# Autodesk Inventor assembly: Ensemble11
(part 2 of 2)
Density: 1 g/cm^3
Appearance: Par défaut
Author: User
Revision Number: NONE
## iProperties of the stored document DGND2.ipt
Created: 2026-11-11
Part Number: DGND2
Material: Générique
Description: PART--DESC
Document SubType Name: Modeling
Designer: User
Density: 1 g/cm^3
Appearance: Par défaut
Author: User
Revision Number: NONE
## iProperties of the stored document P2_1.ipt
Created: 2026-11-11
Part Number: P2
Material: Générique
Description: PART--DESC
Document SubType Name: Modeling
Designer: User
Density: 1 g/cm^3
Appearance: Par défaut
Author: User
Revision Number: NONE
## iProperties of the stored document P1_2.ipt
Created: 2026-11-11
Part Number: P1
Material: Générique
Description: PART--DESC
Document SubType Name: Modeling
Designer: User
Density: 1 g/cm^3
Appearance: Par défaut
Author: User
Revision Number: NONE
## iProperties of the stored document 1_20.ipt
Created: 2026-11-11
Part Number: 1
Material: Générique
Description: PART--DESC
Document SubType Name: Modeling
Designer: User
Density: 1 g/cm^3
Appearance: Par défaut
Author: User
Revision Number: NONE
## iProperties of the stored document 1_13.ipt
Created: 2026-11-11
Part Number: 1
Material: Générique
Description: PART--DESC
Document SubType Name: Modeling
Designer: User
Density: 1 g/cm^3
Appearance: Par défaut
Author: User
Revision Number: NONE
## iProperties of the stored document Camera_module_3_std_model_simple.iam
Created: 2024-01-23
Part Number: Camera_module_3_std_model_simple
Description: STEP AP214
Document SubType Name: Assembly
Designer: User
Title: Camera_module_3_std_model_simple.stp
Revision Number: NONE
Preprocessor: Spatial InterOp 3D
## Documents named in this file (203)
- **D:\Documents\Tibo\ECOLE\NTUST\Intelligent_Control_Systems\Underwater_swarm_project\hardware\CAD_underwater_swarm_project\electronics\RP-008154-DS-1-camera-module-3-step\Ensemble11.iam*LocalDocs*xAaaaq3caAaaaaaaaAaaaqmb0Pf*RESC1005X40N_3.ipt
- **D:\Documents\Tibo\ECOLE\NTUST\Intelligent_Control_Systems\Underwater_swarm_project\hardware\CAD_underwater_swarm_project\electronics\RP-008154-DS-1-camera-module-3-step\Ensemble11.iam*LocalDocs*xAaaaakcaAaaaaaaaAaaaatpnOc*SOT95P280X145-5N_1.ipt
- **D:\Documents\Tibo\ECOLE\NTUST\Intelligent_Control_Systems\Underwater_swarm_project\hardware\CAD_underwater_swarm_project\electronics\RP-008154-DS-1-camera-module-3-step\Ensemble11.iam*LocalDocs*xAaaaaacaAaaaaaaaAaaaq4cuKg*MURATA_DLP11SNXXXHL2.ipt
- **D:\Documents\Tibo\ECOLE\NTUST\Intelligent_Control_Systems\Underwater_swarm_project\hardware\CAD_underwater_swarm_project\electronics\RP-008154-DS-1-camera-module-3-step\Ensemble11.iam*LocalDocs*xAaaaa2aaAaaaaaaaAaaaaoziVc*S2_1.ipt
- **D:\Documents\Tibo\ECOLE\NTUST\Intelligent_Control_Systems\Underwater_swarm_project\hardware\CAD_underwater_swarm_project\electronics\RP-008154-DS-1-camera-module-3-step\Ensemble11.iam*LocalDocs*xAaaaa0caAaaaaaaaAaaaapexYe*NC1.ipt
- **D:\Documents\Tibo\ECOLE\NTUST\Intelligent_Control_Systems\Underwater_swarm_project\hardware\CAD_underwater_swarm_project\electronics\RP-008154-DS-1-camera-module-3-step\Ensemble11.iam*LocalDocs*xAaaaa0baAaaaaaaaAaaaqoilAa*MECHANICAL PIN.ipt
- **D:\Documents\Tibo\ECOLE\NTUST\Intelligent_Control_Systems\Underwater_swarm_project\hardware\CAD_underwater_swarm_project\electronics\RP-008154-DS-1-camera-module-3-step\Ensemble11.iam*LocalDocs*xAaaaa0baAaaaaaaaAaaaaho3Hb*2_22.ipt
- **D:\Documents\Tibo\ECOLE\NTUST\Intelligent_Control_Systems\Underwater_swarm_project\hardware\CAD_underwater_swarm_project\electronics\RP-008154-DS-1-camera-module-3-step\Ensemble11.iam*LocalDocs*xAaaaa0caAaaaaaaaAaaaa30g1a*AFVDD.ipt
- **D:\Documents\Tibo\ECOLE\NTUST\Intelligent_Control_Systems\Underwater_swarm_project\hardware\CAD_underwater_swarm_project\electronics\RP-008154-DS-1-camera-module-3-step\Ensemble11.iam*LocalDocs*xAaaaa0caAaaaaaaaAaaaa4deZg*2_17.ipt
- **D:\Documents\Tibo\ECOLE\NTUST\Intelligent_Control_Systems\Underwater_swarm_project\hardware\CAD_underwater_swarm_project\electronics\RP-008154-DS-1-camera-module-3-step\Ensemble11.iam*LocalDocs*xAaaaa0daAaaaaaaaAaaaqxc0Ec*CAPC2012.ipt
- **D:\Documents\Tibo\ECOLE\NTUST\Intelligent_Control_Systems\Underwater_swarm_project\hardware\CAD_underwater_swarm_project\electronics\RP-008154-DS-1-camera-module-3-step\Ensemble11.iam*LocalDocs*xAaaaa0daAaaaaaaaAaaaqupxTc*1_16.ipt
- **D:\Documents\Tibo\ECOLE\NTUST\Intelligent_Control_Systems\Underwater_swarm_project\hardware\CAD_underwater_swarm_project\electronics\RP-008154-DS-1-camera-module-3-step\Ensemble11.iam*LocalDocs*xAaaaa0daAaaaaaaaAaaaqh0qBd*CAPC1005X55N.ipt
- **D:\Documents\Tibo\ECOLE\NTUST\Intelligent_Control_Systems\Underwater_swarm_project\hardware\CAD_underwater_swarm_project\electronics\RP-008154-DS-1-camera-module-3-step\Ensemble11.iam*LocalDocs*xAaaaa0caAaaaaaaaAaaaqjyvSd*1_4.ipt
- **D:\Documents\Tibo\ECOLE\NTUST\Intelligent_Control_Systems\Underwater_swarm_project\hardware\CAD_underwater_swarm_project\electronics\RP-008154-DS-1-camera-module-3-step\Ensemble11.iam*LocalDocs*xAaaaa0daAaaaaaaaAaaaqx4eFf*1_10.ipt
- **D:\Documents\Tibo\ECOLE\NTUST\Intelligent_Control_Systems\Underwater_swarm_project\hardware\CAD_underwater_swarm_project\electronics\RP-008154-DS-1-camera-module-3-step\Ensemble11.iam*LocalDocs*xAaaaa1caAaaaaaaaAaaaaezlSg*2.ipt
- **D:\Documents\Tibo\ECOLE\NTUST\Intelligent_Control_Systems\Underwater_swarm_project\hardware\CAD_underwater_swarm_project\electronics\RP-008154-DS-1-camera-module-3-step\Ensemble11.iam*LocalDocs*xAaaaa1aaAaaaaaaaAaaaqjprSd*NC1_1.ipt
- **D:\Documents\Tibo\ECOLE\NTUST\Intelligent_Control_Systems\Underwater_swarm_project\hardware\CAD_underwater_swarm_project\electronics\RP-008154-DS-1-camera-module-3-step\Ensemble11.iam*LocalDocs*xAaaaa1daAaaaaaaaAaaaq4cbNf*NC2.ipt
- **D:\Documents\Tibo\ECOLE\NTUST\Intelligent_Control_Systems\Underwater_swarm_project\hardware\CAD_underwater_swarm_project\electronics\RP-008154-DS-1-camera-module-3-step\Ensemble11.iam*LocalDocs*xAaaaa1daAaaaaaaaAaaaawxwAf*15.ipt
- **D:\Documents\Tibo\ECOLE\NTUST\Intelligent_Control_Systems\Underwater_swarm_project\hardware\CAD_underwater_swarm_project\electronics\RP-008154-DS-1-camera-module-3-step\Ensemble11.iam*LocalDocs*xAaaaa1daAaaaaaaaAaaaqe1cPg*1_3.ipt
- **D:\Documents\Tibo\ECOLE\NTUST\Intelligent_Control_Systems\Underwater_swarm_project\hardware\CAD_underwater_swarm_project\electronics\RP-008154-DS-1-camera-module-3-step\Ensemble11.iam*LocalDocs*xAaaaa3daAaaaaaaaAaaaag1kLd*CAPC1608X90N.ipt
- **D:\Documents\Tibo\ECOLE\NTUST\Intelligent_Control_Systems\Underwater_swarm_project\hardware\CAD_underwater_swarm_project\electronics\RP-008154-DS-1-camera-module-3-step\Ensemble11.iam*LocalDocs*xAaaaa3caAaaaaaaaAaaaaj3r2f*CAPC1005X55N_4.ipt
- **D:\Documents\Tibo\ECOLE\NTUST\Intelligent_Control_Systems\Underwater_swarm_project\hardware\CAD_underwater_swarm_project\electronics\RP-008154-DS-1-camera-module-3-step\Ensemble11.iam*LocalDocs*xAaaaa3aaAaaaaaaaAaaaq2yaZg*1_5.ipt
- **D:\Documents\Tibo\ECOLE\NTUST\Intelligent_Control_Systems\Underwater_swarm_project\hardware\CAD_underwater_swarm_project\electronics\RP-008154-DS-1-camera-module-3-step\Ensemble11.iam*LocalDocs*xAaaaa2caAaaaaaaaAaaaahiqGc*MD1N.ipt
- **D:\Documents\Tibo\ECOLE\NTUST\Intelligent_Control_Systems\Underwater_swarm_project\hardware\CAD_underwater_swarm_project\electronics\RP-008154-DS-1-camera-module-3-step\Ensemble11.iam*LocalDocs*xAaaaa3caAaaaaaaaAaaaa3cwCb*NC2_2.ipt
- **D:\Documents\Tibo\ECOLE\NTUST\Intelligent_Control_Systems\Underwater_swarm_project\hardware\CAD_underwater_swarm_project\electronics\RP-008154-DS-1-camera-module-3-step\Ensemble11.iam*LocalDocs*xAaaaa3daAaaaaaaaAaaaa3ktJe*P3.ipt
- **D:\Documents\Tibo\ECOLE\NTUST\Intelligent_Control_Systems\Underwater_swarm_project\hardware\CAD_underwater_swarm_project\electronics\RP-008154-DS-1-camera-module-3-step\Ensemble11.iam*LocalDocs*xAaaaa5baAaaaaaaaAaaaqmyaMe*GND_2.ipt
- **D:\Documents\Tibo\ECOLE\NTUST\Intelligent_Control_Systems\Underwater_swarm_project\hardware\CAD_underwater_swarm_project\electronics\RP-008154-DS-1-camera-module-3-step\Ensemble11.iam*LocalDocs*xAaaaa4caAaaaaaaaAaaaaqewTe*DGND8.ipt
- **D:\Documents\Tibo\ECOLE\NTUST\Intelligent_Control_Systems\Underwater_swarm_project\hardware\CAD_underwater_swarm_project\electronics\RP-008154-DS-1-camera-module-3-step\Ensemble11.iam*LocalDocs*xAaaaa4caAaaaaaaaAaaaanuhYb*2_1.ipt
- **D:\Documents\Tibo\ECOLE\NTUST\Intelligent_Control_Systems\Underwater_swarm_project\hardware\CAD_underwater_swarm_project\electronics\RP-008154-DS-1-camera-module-3-step\Ensemble11.iam*LocalDocs*xAaaaa4aaAaaaaaaaAaaaqdlfUc*1_24.ipt
- **D:\Documents\Tibo\ECOLE\NTUST\Intelligent_Control_Systems\Underwater_swarm_project\hardware\CAD_underwater_swarm_project\electronics\RP-008154-DS-1-camera-module-3-step\Ensemble11.iam*LocalDocs*xAaaaa5aaAaaaaaaaAaaaqanu1g*P1.ipt
- **D:\Documents\Tibo\ECOLE\NTUST\Intelligent_Control_Systems\Underwater_swarm_project\hardware\CAD_underwater_swarm_project\electronics\RP-008154-DS-1-camera-module-3-step\Ensemble11.iam*LocalDocs*xAaaaa5daAaaaaaaaAaaaar3nAf*DVDD_GPIO.ipt
- **D:\Documents\Tibo\ECOLE\NTUST\Intelligent_Control_Systems\Underwater_swarm_project\hardware\CAD_underwater_swarm_project\electronics\RP-008154-DS-1-camera-module-3-step\Ensemble11.iam*LocalDocs*xAaaaaddaAaaaaaaaAaaaask0Ob*VCC.ipt
- **D:\Documents\Tibo\ECOLE\NTUST\Intelligent_Control_Systems\Underwater_swarm_project\hardware\CAD_underwater_swarm_project\electronics\RP-008154-DS-1-camera-module-3-step\Ensemble11.iam*LocalDocs*xAaaaacdaAaaaaaaaAaaaqht53b*EXP_PAD.ipt
- **D:\Documents\Tibo\ECOLE\NTUST\Intelligent_Control_Systems\Underwater_swarm_project\hardware\CAD_underwater_swarm_project\electronics\RP-008154-DS-1-camera-module-3-step\Ensemble11.iam*LocalDocs*xAaaaacaaAaaaaaaaAaaaaoo23b*PG.ipt
- **D:\Documents\Tibo\ECOLE\NTUST\Intelligent_Control_Systems\Underwater_swarm_project\hardware\CAD_underwater_swarm_project\electronics\RP-008154-DS-1-camera-module-3-step\Ensemble11.iam*LocalDocs*xAaaaabdaAaaaaaaaAaaaahbvWa*VDD.ipt
- **D:\Documents\Tibo\ECOLE\NTUST\Intelligent_Control_Systems\Underwater_swarm_project\hardware\CAD_underwater_swarm_project\electronics\RP-008154-DS-1-camera-module-3-step\Ensemble11.iam*LocalDocs*xAaaaabaaAaaaaaaaAaaaqwccBa*G2_1.ipt
- **D:\Documents\Tibo\ECOLE\NTUST\Intelligent_Control_Systems\Underwater_swarm_project\hardware\CAD_underwater_swarm_project\electronics\RP-008154-DS-1-camera-module-3-step\Ensemble11.iam*LocalDocs*xAaaaabdaAaaaaaaaAaaaqdzbBh*GND_1.ipt
- **D:\Documents\Tibo\ECOLE\NTUST\Intelligent_Control_Systems\Underwater_swarm_project\hardware\CAD_underwater_swarm_project\electronics\RP-008154-DS-1-camera-module-3-step\Ensemble11.iam*LocalDocs*xAaaaabdaAaaaaaaaAaaaqi2wRc*12.ipt
- **D:\Documents\Tibo\ECOLE\NTUST\Intelligent_Control_Systems\Underwater_swarm_project\hardware\CAD_underwater_swarm_project\electronics\RP-008154-DS-1-camera-module-3-step\Ensemble11.iam*LocalDocs*xAaaaacdaAaaaaaaaAaaaaiu03a*CAPC1608X90N_1.ipt
- **D:\Documents\Tibo\ECOLE\NTUST\Intelligent_Control_Systems\Underwater_swarm_project\hardware\CAD_underwater_swarm_project\electronics\RP-008154-DS-1-camera-module-3-step\Ensemble11.iam*LocalDocs*xAaaaadcaAaaaaaaaAaaaap5fSc*RESC1005X40N_4.ipt
- **D:\Documents\Tibo\ECOLE\NTUST\Intelligent_Control_Systems\Underwater_swarm_project\hardware\CAD_underwater_swarm_project\electronics\RP-008154-DS-1-camera-module-3-step\Ensemble11.iam*LocalDocs*xAaaaadbaAaaaaaaaAaaaaydeUc*2_5.ipt
- **D:\Documents\Tibo\ECOLE\NTUST\Intelligent_Control_Systems\Underwater_swarm_project\hardware\CAD_underwater_swarm_project\electronics\RP-008154-DS-1-camera-module-3-step\Ensemble11.iam*LocalDocs*xAaaaadaaAaaaaaaaAaaaaixaGf*1_22.ipt
- **D:\Documents\Tibo\ECOLE\NTUST\Intelligent_Control_Systems\Underwater_swarm_project\hardware\CAD_underwater_swarm_project\electronics\RP-008154-DS-1-camera-module-3-step\Ensemble11.iam*LocalDocs*xAaaaadbaAaaaaaaaAaaaqldhHd*G2.ipt
- **D:\Documents\Tibo\ECOLE\NTUST\Intelligent_Control_Systems\Underwater_swarm_project\hardware\CAD_underwater_swarm_project\electronics\RP-008154-DS-1-camera-module-3-step\Ensemble11.iam*LocalDocs*xAaaaaddaAaaaaaaaAaaaaqakVc*ATMEL_ATSHA204A_SOIC8.ipt
- **D:\Documents\Tibo\ECOLE\NTUST\Intelligent_Control_Systems\Underwater_swarm_project\hardware\CAD_underwater_swarm_project\electronics\RP-008154-DS-1-camera-module-3-step\Ensemble11.iam*LocalDocs*xAaaaadcaAaaaaaaaAaaaqixr2b*MD1P.ipt
- **D:\Documents\Tibo\ECOLE\NTUST\Intelligent_Control_Systems\Underwater_swarm_project\hardware\CAD_underwater_swarm_project\electronics\RP-008154-DS-1-camera-module-3-step\Ensemble11.iam*LocalDocs*xAaaaaicaAaaaaaaaAaaaapk0Id*SCL.ipt
- **D:\Documents\Tibo\ECOLE\NTUST\Intelligent_Control_Systems\Underwater_swarm_project\hardware\CAD_underwater_swarm_project\electronics\RP-008154-DS-1-camera-module-3-step\Ensemble11.iam*LocalDocs*xAaaaagdaAaaaaaaaAaaaa1dwOd*2_21.ipt
- **D:\Documents\Tibo\ECOLE\NTUST\Intelligent_Control_Systems\Underwater_swarm_project\hardware\CAD_underwater_swarm_project\electronics\RP-008154-DS-1-camera-module-3-step\Ensemble11.iam*LocalDocs*xAaaaagbaAaaaaaaaAaaaa0wlHa*CAPC1005X55N_1.ipt
- **D:\Documents\Tibo\ECOLE\NTUST\Intelligent_Control_Systems\Underwater_swarm_project\hardware\CAD_underwater_swarm_project\electronics\RP-008154-DS-1-camera-module-3-step\Ensemble11.iam*LocalDocs*xAaaaaecaAaaaaaaaAaaaazxhGb*SDA.ipt
- **D:\Documents\Tibo\ECOLE\NTUST\Intelligent_Control_Systems\Underwater_swarm_project\hardware\CAD_underwater_swarm_project\electronics\RP-008154-DS-1-camera-module-3-step\Ensemble11.iam*LocalDocs*xAaaaagaaAaaaaaaaAaaaqolcLd*1_7.ipt
- **D:\Documents\Tibo\ECOLE\NTUST\Intelligent_Control_Systems\Underwater_swarm_project\hardware\CAD_underwater_swarm_project\electronics\RP-008154-DS-1-camera-module-3-step\Ensemble11.iam*LocalDocs*xAaaaagbaAaaaaaaaAaaaqvkuBg*1_14.ipt
- **D:\Documents\Tibo\ECOLE\NTUST\Intelligent_Control_Systems\Underwater_swarm_project\hardware\CAD_underwater_swarm_project\electronics\RP-008154-DS-1-camera-module-3-step\Ensemble11.iam*LocalDocs*xAaaaaiaaAaaaaaaaAaaaq4fxAg*2_23.ipt
- **D:\Documents\Tibo\ECOLE\NTUST\Intelligent_Control_Systems\Underwater_swarm_project\hardware\CAD_underwater_swarm_project\electronics\RP-008154-DS-1-camera-module-3-step\Ensemble11.iam*LocalDocs*xAaaaaiaaAaaaaaaaAaaaa2p5Gf*2_3.ipt
- **D:\Documents\Tibo\ECOLE\NTUST\Intelligent_Control_Systems\Underwater_swarm_project\hardware\CAD_underwater_swarm_project\electronics\RP-008154-DS-1-camera-module-3-step\Ensemble11.iam*LocalDocs*xAaaaahbaAaaaaaaaAaaaqledLc*1.ipt
- **D:\Documents\Tibo\ECOLE\NTUST\Intelligent_Control_Systems\Underwater_swarm_project\hardware\CAD_underwater_swarm_project\electronics\RP-008154-DS-1-camera-module-3-step\Ensemble11.iam*LocalDocs*xAaaaaibaAaaaaaaaAaaaaiedIe*LX.ipt
- **D:\Documents\Tibo\ECOLE\NTUST\Intelligent_Control_Systems\Underwater_swarm_project\hardware\CAD_underwater_swarm_project\electronics\RP-008154-DS-1-camera-module-3-step\Ensemble11.iam*LocalDocs*xAaaaajaaAaaaaaaaAaaaaghbLb*P4_2.ipt
- **D:\Documents\Tibo\ECOLE\NTUST\Intelligent_Control_Systems\Underwater_swarm_project\hardware\CAD_underwater_swarm_project\electronics\RP-008154-DS-1-camera-module-3-step\Ensemble11.iam*LocalDocs*xAaaaaicaAaaaaaaaAaaaqbqu2f*8.ipt
- **D:\Documents\Tibo\ECOLE\NTUST\Intelligent_Control_Systems\Underwater_swarm_project\hardware\CAD_underwater_swarm_project\electronics\RP-008154-DS-1-camera-module-3-step\Ensemble11.iam*LocalDocs*xAaaaakbaAaaaaaaaAaaaqlrc5g*MCKP.ipt
- **D:\Documents\Tibo\ECOLE\NTUST\Intelligent_Control_Systems\Underwater_swarm_project\hardware\CAD_underwater_swarm_project\electronics\RP-008154-DS-1-camera-module-3-step\Ensemble11.iam*LocalDocs*xAaaaajdaAaaaaaaaAaaaaywoSc*DVDD.ipt
- **D:\Documents\Tibo\ECOLE\NTUST\Intelligent_Control_Systems\Underwater_swarm_project\hardware\CAD_underwater_swarm_project\electronics\RP-008154-DS-1-camera-module-3-step\Ensemble11.iam*LocalDocs*xAaaaaraaAaaaaaaaAaaaab434f*VO1V8.ipt
- **D:\Documents\Tibo\ECOLE\NTUST\Intelligent_Control_Systems\Underwater_swarm_project\hardware\CAD_underwater_swarm_project\electronics\RP-008154-DS-1-camera-module-3-step\Ensemble11.iam*LocalDocs*xAaaaaodaAaaaaaaaAaaaavohMa*ATMEL_ATSHA204A_8UDFN.ipt
- **D:\Documents\Tibo\ECOLE\NTUST\Intelligent_Control_Systems\Underwater_swarm_project\hardware\CAD_underwater_swarm_project\electronics\RP-008154-DS-1-camera-module-3-step\Ensemble11.iam*LocalDocs*xAaaaanbaAaaaaaaaAaaaayklCa*DGND3.ipt
- **D:\Documents\Tibo\ECOLE\NTUST\Intelligent_Control_Systems\Underwater_swarm_project\hardware\CAD_underwater_swarm_project\electronics\RP-008154-DS-1-camera-module-3-step\Ensemble11.iam*LocalDocs*xAaaaamaaAaaaaaaaAaaaqpq43e*7.ipt
- **D:\Documents\Tibo\ECOLE\NTUST\Intelligent_Control_Systems\Underwater_swarm_project\hardware\CAD_underwater_swarm_project\electronics\RP-008154-DS-1-camera-module-3-step\Ensemble11.iam*LocalDocs*xAaaaalcaAaaaaaaaAaaaqzdtUd*D2_1.ipt
- **D:\Documents\Tibo\ECOLE\NTUST\Intelligent_Control_Systems\Underwater_swarm_project\hardware\CAD_underwater_swarm_project\electronics\RP-008154-DS-1-camera-module-3-step\Ensemble11.iam*LocalDocs*xAaaaakcaAaaaaaaaAaaaqdztIf*1_2.ipt
- **D:\Documents\Tibo\ECOLE\NTUST\Intelligent_Control_Systems\Underwater_swarm_project\hardware\CAD_underwater_swarm_project\electronics\RP-008154-DS-1-camera-module-3-step\Ensemble11.iam*LocalDocs*xAaaaalaaAaaaaaaaAaaaajuyCe*_PWDN.ipt
- **D:\Documents\Tibo\ECOLE\NTUST\Intelligent_Control_Systems\Underwater_swarm_project\hardware\CAD_underwater_swarm_project\electronics\RP-008154-DS-1-camera-module-3-step\Ensemble11.iam*LocalDocs*xAaaaaldaAaaaaaaaAaaaqsx33f*1_1.ipt
- **D:\Documents\Tibo\ECOLE\NTUST\Intelligent_Control_Systems\Underwater_swarm_project\hardware\CAD_underwater_swarm_project\electronics\RP-008154-DS-1-camera-module-3-step\Ensemble11.iam*LocalDocs*xAaaaambaAaaaaaaaAaaaass0Va*OUTPUT.ipt
- **D:\Documents\Tibo\ECOLE\NTUST\Intelligent_Control_Systems\Underwater_swarm_project\hardware\CAD_underwater_swarm_project\electronics\RP-008154-DS-1-camera-module-3-step\Ensemble11.iam*LocalDocs*xAaaaaoaaAaaaaaaaAaaaqalgOg*CAPC1005X55N_2.ipt
- **D:\Documents\Tibo\ECOLE\NTUST\Intelligent_Control_Systems\Underwater_swarm_project\hardware\CAD_underwater_swarm_project\electronics\RP-008154-DS-1-camera-module-3-step\Ensemble11.iam*LocalDocs*xAaaaandaAaaaaaaaAaaaqwfnDb*CAPC1005X55N_5.ipt
- **D:\Documents\Tibo\ECOLE\NTUST\Intelligent_Control_Systems\Underwater_swarm_project\hardware\CAD_underwater_swarm_project\electronics\RP-008154-DS-1-camera-module-3-step\Ensemble11.iam*LocalDocs*xAaaaaocaAaaaaaaaAaaaanebPb*EN_1.ipt
- **D:\Documents\Tibo\ECOLE\NTUST\Intelligent_Control_Systems\Underwater_swarm_project\hardware\CAD_underwater_swarm_project\electronics\RP-008154-DS-1-camera-module-3-step\Ensemble11.iam*LocalDocs*xAaaaaoaaAaaaaaaaAaaaqic3Qg*2_9.ipt
- **D:\Documents\Tibo\ECOLE\NTUST\Intelligent_Control_Systems\Underwater_swarm_project\hardware\CAD_underwater_swarm_project\electronics\RP-008154-DS-1-camera-module-3-step\Ensemble11.iam*LocalDocs*xAaaaaocaAaaaaaaaAaaaqk2sSc*OE.ipt
- **D:\Documents\Tibo\ECOLE\NTUST\Intelligent_Control_Systems\Underwater_swarm_project\hardware\CAD_underwater_swarm_project\electronics\RP-008154-DS-1-camera-module-3-step\Ensemble11.iam*LocalDocs*xAaaaaqcaAaaaaaaaAaaaa5znVf*MURATA_DLP11SNXXXHL2_2.ipt
- **D:\Documents\Tibo\ECOLE\NTUST\Intelligent_Control_Systems\Underwater_swarm_project\hardware\CAD_underwater_swarm_project\electronics\RP-008154-DS-1-camera-module-3-step\Ensemble11.iam*LocalDocs*xAaaaapaaAaaaaaaaAaaaqle5Ch*P2.ipt
- **D:\Documents\Tibo\ECOLE\NTUST\Intelligent_Control_Systems\Underwater_swarm_project\hardware\CAD_underwater_swarm_project\electronics\RP-008154-DS-1-camera-module-3-step\Ensemble11.iam*LocalDocs*xAaaaapaaAaaaaaaaAaaaanlw1a*NC2_1.ipt
- **D:\Documents\Tibo\ECOLE\NTUST\Intelligent_Control_Systems\Underwater_swarm_project\hardware\CAD_underwater_swarm_project\electronics\RP-008154-DS-1-camera-module-3-step\Ensemble11.iam*LocalDocs*xAaaaaqcaAaaaaaaaAaaaaswdYd*Shapes.iam
- **D:\Documents\Tibo\ECOLE\NTUST\Intelligent_Control_Systems\Underwater_swarm_project\hardware\CAD_underwater_swarm_project\electronics\RP-008154-DS-1-camera-module-3-step\Ensemble11.iam*LocalDocs*xAaaaqeaaAaaaaaaaAaaaava3He*SILKSCREEN_TOP.ipt
- **D:\Documents\Tibo\ECOLE\NTUST\Intelligent_Control_Systems\Underwater_swarm_project\hardware\CAD_underwater_swarm_project\electronics\RP-008154-DS-1-camera-module-3-step\Ensemble11.iam*LocalDocs*xAaaaq2aaAaaaaaaaAaaaq4ynBf*PASTEMASK_TOP.ipt
- **D:\Documents\Tibo\ECOLE\NTUST\Intelligent_Control_Systems\Underwater_swarm_project\hardware\CAD_underwater_swarm_project\electronics\RP-008154-DS-1-camera-module-3-step\Ensemble11.iam*LocalDocs*xAaaaqcbaAaaaaaaaAaaaqzlqJg*SOLDERMASK_TOP.ipt
- **D:\Documents\Tibo\ECOLE\NTUST\Intelligent_Control_Systems\Underwater_swarm_project\hardware\CAD_underwater_swarm_project\electronics\RP-008154-DS-1-camera-module-3-step\Ensemble11.iam*LocalDocs*xAaaaqucaAaaaaaaaAaaaq3ckGd*Dielectric.ipt
- **D:\Documents\Tibo\ECOLE\NTUST\Intelligent_Control_Systems\Underwater_swarm_project\hardware\CAD_underwater_swarm_project\electronics\RP-008154-DS-1-camera-module-3-step\Ensemble11.iam*LocalDocs*xAaaaqfbaAaaaaaaaAaaaac4sNf*SOLDERMASK_BOTTOM.ipt
- **D:\Documents\Tibo\ECOLE\NTUST\Intelligent_Control_Systems\Underwater_swarm_project\hardware\CAD_underwater_swarm_project\electronics\RP-008154-DS-1-camera-module-3-step\Ensemble11.iam*LocalDocs*xAaaaq4aaAaaaaaaaAaaaaka5Fa*PASTEMASK_BOTTOM.ipt
- **D:\Documents\Tibo\ECOLE\NTUST\Intelligent_Control_Systems\Underwater_swarm_project\hardware\CAD_underwater_swarm_project\electronics\RP-008154-DS-1-camera-module-3-step\Ensemble11.iam*LocalDocs*xAaaaataaAaaaaaaaAaaaa25fTh*SILKSCREEN_BOTTOM.ipt
- **D:\Documents\Tibo\ECOLE\NTUST\Intelligent_Control_Systems\Underwater_swarm_project\hardware\CAD_underwater_swarm_project\electronics\RP-008154-DS-1-camera-module-3-step\Ensemble11.iam*LocalDocs*xAaaaaqcaAaaaaaaaAaaaassyQh*GND_6.ipt
- **D:\Documents\Tibo\ECOLE\NTUST\Intelligent_Control_Systems\Underwater_swarm_project\hardware\CAD_underwater_swarm_project\electronics\RP-008154-DS-1-camera-module-3-step\Ensemble11.iam*LocalDocs*xAaaaaudaAaaaaaaaAaaaq0wy3a*RESC1005X40N_1.ipt
- **D:\Documents\Tibo\ECOLE\NTUST\Intelligent_Control_Systems\Underwater_swarm_project\hardware\CAD_underwater_swarm_project\electronics\RP-008154-DS-1-camera-module-3-step\Ensemble11.iam*LocalDocs*xAaaaascaAaaaaaaaAaaaqvdpYg*P4.ipt
- **D:\Documents\Tibo\ECOLE\NTUST\Intelligent_Control_Systems\Underwater_swarm_project\hardware\CAD_underwater_swarm_project\electronics\RP-008154-DS-1-camera-module-3-step\Ensemble11.iam*LocalDocs*xAaaaarcaAaaaaaaaAaaaq03kGe*NC3.ipt
- **D:\Documents\Tibo\ECOLE\NTUST\Intelligent_Control_Systems\Underwater_swarm_project\hardware\CAD_underwater_swarm_project\electronics\RP-008154-DS-1-camera-module-3-step\Ensemble11.iam*LocalDocs*xAaaaaraaAaaaaaaaAaaaqquqDe*MECHANICAL PIN_2.ipt
- **D:\Documents\Tibo\ECOLE\NTUST\Intelligent_Control_Systems\Underwater_swarm_project\hardware\CAD_underwater_swarm_project\electronics\RP-008154-DS-1-camera-module-3-step\Ensemble11.iam*LocalDocs*xAaaaardaAaaaaaaaAaaaqvfcJc*NC6.ipt
- **D:\Documents\Tibo\ECOLE\NTUST\Intelligent_Control_Systems\Underwater_swarm_project\hardware\CAD_underwater_swarm_project\electronics\RP-008154-DS-1-camera-module-3-step\Ensemble11.iam*LocalDocs*xAaaaardaAaaaaaaaAaaaav2gTh*GND_3.ipt
- **D:\Documents\Tibo\ECOLE\NTUST\Intelligent_Control_Systems\Underwater_swarm_project\hardware\CAD_underwater_swarm_project\electronics\RP-008154-DS-1-camera-module-3-step\Ensemble11.iam*LocalDocs*xAaaaasaaAaaaaaaaAaaaarafNa*DGND6.ipt
- **D:\Documents\Tibo\ECOLE\NTUST\Intelligent_Control_Systems\Underwater_swarm_project\hardware\CAD_underwater_swarm_project\electronics\RP-008154-DS-1-camera-module-3-step\Ensemble11.iam*LocalDocs*xAaaaasdaAaaaaaaaAaaaaubtSb*P4_1.ipt
- **D:\Documents\Tibo\ECOLE\NTUST\Intelligent_Control_Systems\Underwater_swarm_project\hardware\CAD_underwater_swarm_project\electronics\RP-008154-DS-1-camera-module-3-step\Ensemble11.iam*LocalDocs*xAaaaaucaAaaaaaaaAaaaanimEg*2_14.ipt
- **D:\Documents\Tibo\ECOLE\NTUST\Intelligent_Control_Systems\Underwater_swarm_project\hardware\CAD_underwater_swarm_project\electronics\RP-008154-DS-1-camera-module-3-step\Ensemble11.iam*LocalDocs*xAaaaataaAaaaaaaaAaaaajgq0b*FCI_SFW15R-1STE1LF.ipt
- **D:\Documents\Tibo\ECOLE\NTUST\Intelligent_Control_Systems\Underwater_swarm_project\hardware\CAD_underwater_swarm_project\electronics\RP-008154-DS-1-camera-module-3-step\Ensemble11.iam*LocalDocs*xAaaaatdaAaaaaaaaAaaaqk3zNc*1_23.ipt
- **D:\Documents\Tibo\ECOLE\NTUST\Intelligent_Control_Systems\Underwater_swarm_project\hardware\CAD_underwater_swarm_project\electronics\RP-008154-DS-1-camera-module-3-step\Ensemble11.iam*LocalDocs*xAaaaaucaAaaaaaaaAaaaawafGc*P3_2.ipt
- **D:\Documents\Tibo\ECOLE\NTUST\Intelligent_Control_Systems\Underwater_swarm_project\hardware\CAD_underwater_swarm_project\electronics\RP-008154-DS-1-camera-module-3-step\Ensemble11.iam*LocalDocs*xAaaaq0aaAaaaaaaaAaaaqggeIe*CAPC1005X55N_8.ipt
- **D:\Documents\Tibo\ECOLE\NTUST\Intelligent_Control_Systems\Underwater_swarm_project\hardware\CAD_underwater_swarm_project\electronics\RP-008154-DS-1-camera-module-3-step\Ensemble11.iam*LocalDocs*xAaaaaxaaAaaaaaaaAaaaqbhoOa*CAPC1608.ipt
- **D:\Documents\Tibo\ECOLE\NTUST\Intelligent_Control_Systems\Underwater_swarm_project\hardware\CAD_underwater_swarm_project\electronics\RP-008154-DS-1-camera-module-3-step\Ensemble11.iam*LocalDocs*xAaaaavdaAaaaaaaaAaaaacdaPb*5.ipt
- **D:\Documents\Tibo\ECOLE\NTUST\Intelligent_Control_Systems\Underwater_swarm_project\hardware\CAD_underwater_swarm_project\electronics\RP-008154-DS-1-camera-module-3-step\Ensemble11.iam*LocalDocs*xAaaaaudaAaaaaaaaAaaaq5wmKb*RESC0603.ipt
- **D:\Documents\Tibo\ECOLE\NTUST\Intelligent_Control_Systems\Underwater_swarm_project\hardware\CAD_underwater_swarm_project\electronics\RP-008154-DS-1-camera-module-3-step\Ensemble11.iam*LocalDocs*xAaaaawcaAaaaaaaaAaaaqzmcFc*GND_5.ipt
- **D:\Documents\Tibo\ECOLE\NTUST\Intelligent_Control_Systems\Underwater_swarm_project\hardware\CAD_underwater_swarm_project\electronics\RP-008154-DS-1-camera-module-3-step\Ensemble11.iam*LocalDocs*xAaaaawaaAaaaaaaaAaaaaigz0c*1_15.ipt
- **D:\Documents\Tibo\ECOLE\NTUST\Intelligent_Control_Systems\Underwater_swarm_project\hardware\CAD_underwater_swarm_project\electronics\RP-008154-DS-1-camera-module-3-step\Ensemble11.iam*LocalDocs*xAaaaavdaAaaaaaaaAaaaappnId*Pins.iam
- **D:\Documents\Tibo\ECOLE\NTUST\Intelligent_Control_Systems\Underwater_swarm_project\hardware\CAD_underwater_swarm_project\electronics\RP-008154-DS-1-camera-module-3-step\Ensemble11.iam*LocalDocs*xAaaaqwaaAaaaaaaaAaaaqlbjEg*1_6.ipt
- **D:\Documents\Tibo\ECOLE\NTUST\Intelligent_Control_Systems\Underwater_swarm_project\hardware\CAD_underwater_swarm_project\electronics\RP-008154-DS-1-camera-module-3-step\Ensemble11.iam*LocalDocs*xAaaaqycaAaaaaaaaAaaaa2aiOh*1_8.ipt
- **D:\Documents\Tibo\ECOLE\NTUST\Intelligent_Control_Systems\Underwater_swarm_project\hardware\CAD_underwater_swarm_project\electronics\RP-008154-DS-1-camera-module-3-step\Ensemble11.iam*LocalDocs*xAaaaqpdaAaaaaaaaAaaaagg2Vc*1_9.ipt
- **D:\Documents\Tibo\ECOLE\NTUST\Intelligent_Control_Systems\Underwater_swarm_project\hardware\CAD_underwater_swarm_project\electronics\RP-008154-DS-1-camera-module-3-step\Ensemble11.iam*LocalDocs*xAaaaqfaaAaaaaaaaAaaaat2f4f*1_11.ipt
- **D:\Documents\Tibo\ECOLE\NTUST\Intelligent_Control_Systems\Underwater_swarm_project\hardware\CAD_underwater_swarm_project\electronics\RP-008154-DS-1-camera-module-3-step\Ensemble11.iam*LocalDocs*xAaaaqeaaAaaaaaaaAaaaq3iwXf*1_12.ipt
- **D:\Documents\Tibo\ECOLE\NTUST\Intelligent_Control_Systems\Underwater_swarm_project\hardware\CAD_underwater_swarm_project\electronics\RP-008154-DS-1-camera-module-3-step\Ensemble11.iam*LocalDocs*xAaaaqzcaAaaaaaaaAaaaasbjQc*1_13.ipt
- **D:\Documents\Tibo\ECOLE\NTUST\Intelligent_Control_Systems\Underwater_swarm_project\hardware\CAD_underwater_swarm_project\electronics\RP-008154-DS-1-camera-module-3-step\Ensemble11.iam*LocalDocs*xAaaaqabaAaaaaaaaAaaaqoqkMd*1_17.ipt
- **D:\Documents\Tibo\ECOLE\NTUST\Intelligent_Control_Systems\Underwater_swarm_project\hardware\CAD_underwater_swarm_project\electronics\RP-008154-DS-1-camera-module-3-step\Ensemble11.iam*LocalDocs*xAaaaqdcaAaaaaaaaAaaaqireNg*1_18.ipt
- **D:\Documents\Tibo\ECOLE\NTUST\Intelligent_Control_Systems\Underwater_swarm_project\hardware\CAD_underwater_swarm_project\electronics\RP-008154-DS-1-camera-module-3-step\Ensemble11.iam*LocalDocs*xAaaaqtcaAaaaaaaaAaaaqfplGb*1_19.ipt
- **D:\Documents\Tibo\ECOLE\NTUST\Intelligent_Control_Systems\Underwater_swarm_project\hardware\CAD_underwater_swarm_project\electronics\RP-008154-DS-1-camera-module-3-step\Ensemble11.iam*LocalDocs*xAaaaqycaAaaaaaaaAaaaqy5iYb*1_20.ipt
- **D:\Documents\Tibo\ECOLE\NTUST\Intelligent_Control_Systems\Underwater_swarm_project\hardware\CAD_underwater_swarm_project\electronics\RP-008154-DS-1-camera-module-3-step\Ensemble11.iam*LocalDocs*xAaaaquaaAaaaaaaaAaaaaod15e*1_21.ipt
- **D:\Documents\Tibo\ECOLE\NTUST\Intelligent_Control_Systems\Underwater_swarm_project\hardware\CAD_underwater_swarm_project\electronics\RP-008154-DS-1-camera-module-3-step\Ensemble11.iam*LocalDocs*xAaaaq3aaAaaaaaaaAaaaqkfkDf*10.ipt
- **D:\Documents\Tibo\ECOLE\NTUST\Intelligent_Control_Systems\Underwater_swarm_project\hardware\CAD_underwater_swarm_project\electronics\RP-008154-DS-1-camera-module-3-step\Ensemble11.iam*LocalDocs*xAaaaqnaaAaaaaaaaAaaaa3ap2b*11.ipt
- **D:\Documents\Tibo\ECOLE\NTUST\Intelligent_Control_Systems\Underwater_swarm_project\hardware\CAD_underwater_swarm_project\electronics\RP-008154-DS-1-camera-module-3-step\Ensemble11.iam*LocalDocs*xAaaaqqcaAaaaaaaaAaaaa1x1Kh*13.ipt
- **D:\Documents\Tibo\ECOLE\NTUST\Intelligent_Control_Systems\Underwater_swarm_project\hardware\CAD_underwater_swarm_project\electronics\RP-008154-DS-1-camera-module-3-step\Ensemble11.iam*LocalDocs*xAaaaqwcaAaaaaaaaAaaaaowiHe*14.ipt
- **D:\Documents\Tibo\ECOLE\NTUST\Intelligent_Control_Systems\Underwater_swarm_project\hardware\CAD_underwater_swarm_project\electronics\RP-008154-DS-1-camera-module-3-step\Ensemble11.iam*LocalDocs*xAaaaaydaAaaaaaaaAaaaa5vyNc*2_2.ipt
- **D:\Documents\Tibo\ECOLE\NTUST\Intelligent_Control_Systems\Underwater_swarm_project\hardware\CAD_underwater_swarm_project\electronics\RP-008154-DS-1-camera-module-3-step\Ensemble11.iam*LocalDocs*xAaaaqgdaAaaaaaaaAaaaqkap1f*2_4.ipt
- **D:\Documents\Tibo\ECOLE\NTUST\Intelligent_Control_Systems\Underwater_swarm_project\hardware\CAD_underwater_swarm_project\electronics\RP-008154-DS-1-camera-module-3-step\Ensemble11.iam*LocalDocs*xAaaaqecaAaaaaaaaAaaaah4nJd*2_6.ipt
- **D:\Documents\Tibo\ECOLE\NTUST\Intelligent_Control_Systems\Underwater_swarm_project\hardware\CAD_underwater_swarm_project\electronics\RP-008154-DS-1-camera-module-3-step\Ensemble11.iam*LocalDocs*xAaaaq0aaAaaaaaaaAaaaadzxCc*2_7.ipt
- **D:\Documents\Tibo\ECOLE\NTUST\Intelligent_Control_Systems\Underwater_swarm_project\hardware\CAD_underwater_swarm_project\electronics\RP-008154-DS-1-camera-module-3-step\Ensemble11.iam*LocalDocs*xAaaaazbaAaaaaaaaAaaaqunkXb*2_8.ipt
- **D:\Documents\Tibo\ECOLE\NTUST\Intelligent_Control_Systems\Underwater_swarm_project\hardware\CAD_underwater_swarm_project\electronics\RP-008154-DS-1-camera-module-3-step\Ensemble11.iam*LocalDocs*xAaaaqhaaAaaaaaaaAaaaafaxIf*2_10.ipt
- **D:\Documents\Tibo\ECOLE\NTUST\Intelligent_Control_Systems\Underwater_swarm_project\hardware\CAD_underwater_swarm_project\electronics\RP-008154-DS-1-camera-module-3-step\Ensemble11.iam*LocalDocs*xAaaaqybaAaaaaaaaAaaaagcgPg*2_11.ipt
- **D:\Documents\Tibo\ECOLE\NTUST\Intelligent_Control_Systems\Underwater_swarm_project\hardware\CAD_underwater_swarm_project\electronics\RP-008154-DS-1-camera-module-3-step\Ensemble11.iam*LocalDocs*xAaaaqkcaAaaaaaaaAaaaqd1dWc*2_12.ipt
- **D:\Documents\Tibo\ECOLE\NTUST\Intelligent_Control_Systems\Underwater_swarm_project\hardware\CAD_underwater_swarm_project\electronics\RP-008154-DS-1-camera-module-3-step\Ensemble11.iam*LocalDocs*xAaaaqibaAaaaaaaaAaaaqu4a3f*2_13.ipt
- **D:\Documents\Tibo\ECOLE\NTUST\Intelligent_Control_Systems\Underwater_swarm_project\hardware\CAD_underwater_swarm_project\electronics\RP-008154-DS-1-camera-module-3-step\Ensemble11.iam*LocalDocs*xAaaaqdcaAaaaaaaaAaaaaqsfLd*2_15.ipt
- **D:\Documents\Tibo\ECOLE\NTUST\Intelligent_Control_Systems\Underwater_swarm_project\hardware\CAD_underwater_swarm_project\electronics\RP-008154-DS-1-camera-module-3-step\Ensemble11.iam*LocalDocs*xAaaaaxaaAaaaaaaaAaaaaldzSd*2_16.ipt
- **D:\Documents\Tibo\ECOLE\NTUST\Intelligent_Control_Systems\Underwater_swarm_project\hardware\CAD_underwater_swarm_project\electronics\RP-008154-DS-1-camera-module-3-step\Ensemble11.iam*LocalDocs*xAaaaqxbaAaaaaaaaAaaaabsmAc*2_18.ipt
- **D:\Documents\Tibo\ECOLE\NTUST\Intelligent_Control_Systems\Underwater_swarm_project\hardware\CAD_underwater_swarm_project\electronics\RP-008154-DS-1-camera-module-3-step\Ensemble11.iam*LocalDocs*xAaaaqjdaAaaaaaaaAaaaqjwsHf*2_19.ipt
- **D:\Documents\Tibo\ECOLE\NTUST\Intelligent_Control_Systems\Underwater_swarm_project\hardware\CAD_underwater_swarm_project\electronics\RP-008154-DS-1-camera-module-3-step\Ensemble11.iam*LocalDocs*xAaaaq3daAaaaaaaaAaaaqfbkVg*2_20.ipt
- **D:\Documents\Tibo\ECOLE\NTUST\Intelligent_Control_Systems\Underwater_swarm_project\hardware\CAD_underwater_swarm_project\electronics\RP-008154-DS-1-camera-module-3-step\Ensemble11.iam*LocalDocs*xAaaaqiaaAaaaaaaaAaaaqprjRd*2_24.ipt
- **D:\Documents\Tibo\ECOLE\NTUST\Intelligent_Control_Systems\Underwater_swarm_project\hardware\CAD_underwater_swarm_project\electronics\RP-008154-DS-1-camera-module-3-step\Ensemble11.iam*LocalDocs*xAaaaaxaaAaaaaaaaAaaaqza4Zb*3.ipt
- **D:\Documents\Tibo\ECOLE\NTUST\Intelligent_Control_Systems\Underwater_swarm_project\hardware\CAD_underwater_swarm_project\electronics\RP-008154-DS-1-camera-module-3-step\Ensemble11.iam*LocalDocs*xAaaaqfaaAaaaaaaaAaaaa5ygIe*4.ipt
- **D:\Documents\Tibo\ECOLE\NTUST\Intelligent_Control_Systems\Underwater_swarm_project\hardware\CAD_underwater_swarm_project\electronics\RP-008154-DS-1-camera-module-3-step\Ensemble11.iam*LocalDocs*xAaaaqicaAaaaaaaaAaaaa3ttWb*6.ipt
- **D:\Documents\Tibo\ECOLE\NTUST\Intelligent_Control_Systems\Underwater_swarm_project\hardware\CAD_underwater_swarm_project\electronics\RP-008154-DS-1-camera-module-3-step\Ensemble11.iam*LocalDocs*xAaaaaycaAaaaaaaaAaaaapypDb*9.ipt
- **D:\Documents\Tibo\ECOLE\NTUST\Intelligent_Control_Systems\Underwater_swarm_project\hardware\CAD_underwater_swarm_project\electronics\RP-008154-DS-1-camera-module-3-step\Ensemble11.iam*LocalDocs*xAaaaq5caAaaaaaaaAaaaamyiYg*AGND.ipt
- **D:\Documents\Tibo\ECOLE\NTUST\Intelligent_Control_Systems\Underwater_swarm_project\hardware\CAD_underwater_swarm_project\electronics\RP-008154-DS-1-camera-module-3-step\Ensemble11.iam*LocalDocs*xAaaaqucaAaaaaaaaAaaaaritWe*D2.ipt
- **D:\Documents\Tibo\ECOLE\NTUST\Intelligent_Control_Systems\Underwater_swarm_project\hardware\CAD_underwater_swarm_project\electronics\RP-008154-DS-1-camera-module-3-step\Ensemble11.iam*LocalDocs*xAaaaq4baAaaaaaaaAaaaa1rvUa*DGND1.ipt
- **D:\Documents\Tibo\ECOLE\NTUST\Intelligent_Control_Systems\Underwater_swarm_project\hardware\CAD_underwater_swarm_project\electronics\RP-008154-DS-1-camera-module-3-step\Ensemble11.iam*LocalDocs*xAaaaqycaAaaaaaaaAaaaqntgJb*DGND2.ipt
- **D:\Documents\Tibo\ECOLE\NTUST\Intelligent_Control_Systems\Underwater_swarm_project\hardware\CAD_underwater_swarm_project\electronics\RP-008154-DS-1-camera-module-3-step\Ensemble11.iam*LocalDocs*xAaaaqocaAaaaaaaaAaaaqsjy5c*DGND4.ipt
- **D:\Documents\Tibo\ECOLE\NTUST\Intelligent_Control_Systems\Underwater_swarm_project\hardware\CAD_underwater_swarm_project\electronics\RP-008154-DS-1-camera-module-3-step\Ensemble11.iam*LocalDocs*xAaaaqlaaAaaaaaaaAaaaaafnYh*DGND5.ipt
- **D:\Documents\Tibo\ECOLE\NTUST\Intelligent_Control_Systems\Underwater_swarm_project\hardware\CAD_underwater_swarm_project\electronics\RP-008154-DS-1-camera-module-3-step\Ensemble11.iam*LocalDocs*xAaaaqdbaAaaaaaaaAaaaq53qGd*DGND7.ipt
- **D:\Documents\Tibo\ECOLE\NTUST\Intelligent_Control_Systems\Underwater_swarm_project\hardware\CAD_underwater_swarm_project\electronics\RP-008154-DS-1-camera-module-3-step\Ensemble11.iam*LocalDocs*xAaaaqjaaAaaaaaaaAaaaavc3Mf*DGND9.ipt
- **D:\Documents\Tibo\ECOLE\NTUST\Intelligent_Control_Systems\Underwater_swarm_project\hardware\CAD_underwater_swarm_project\electronics\RP-008154-DS-1-camera-module-3-step\Ensemble11.iam*LocalDocs*xAaaaqkbaAaaaaaaaAaaaq1p0Zf*EN.ipt
- **D:\Documents\Tibo\ECOLE\NTUST\Intelligent_Control_Systems\Underwater_swarm_project\hardware\CAD_underwater_swarm_project\electronics\RP-008154-DS-1-camera-module-3-step\Ensemble11.iam*LocalDocs*xAaaaqbbaAaaaaaaaAaaaaivuWb*EN_2.ipt
- **D:\Documents\Tibo\ECOLE\NTUST\Intelligent_Control_Systems\Underwater_swarm_project\hardware\CAD_underwater_swarm_project\electronics\RP-008154-DS-1-camera-module-3-step\Ensemble11.iam*LocalDocs*xAaaaq3baAaaaaaaaAaaaalxuIf*FB.ipt
- **D:\Documents\Tibo\ECOLE\NTUST\Intelligent_Control_Systems\Underwater_swarm_project\hardware\CAD_underwater_swarm_project\electronics\RP-008154-DS-1-camera-module-3-step\Ensemble11.iam*LocalDocs*xAaaaq2caAaaaaaaaAaaaqp32He*GND.ipt
- **D:\Documents\Tibo\ECOLE\NTUST\Intelligent_Control_Systems\Underwater_swarm_project\hardware\CAD_underwater_swarm_project\electronics\RP-008154-DS-1-camera-module-3-step\Ensemble11.iam*LocalDocs*xAaaaq4baAaaaaaaaAaaaaplo4g*GND_4.ipt
- **D:\Documents\Tibo\ECOLE\NTUST\Intelligent_Control_Systems\Underwater_swarm_project\hardware\CAD_underwater_swarm_project\electronics\RP-008154-DS-1-camera-module-3-step\Ensemble11.iam*LocalDocs*xAaaaquaaAaaaaaaaAaaaaqsaFc*IN.ipt
- **D:\Documents\Tibo\ECOLE\NTUST\Intelligent_Control_Systems\Underwater_swarm_project\hardware\CAD_underwater_swarm_project\electronics\RP-008154-DS-1-camera-module-3-step\Ensemble11.iam*LocalDocs*xAaaaqnbaAaaaaaaaAaaaqzroDb*IN_1.ipt
- **D:\Documents\Tibo\ECOLE\NTUST\Intelligent_Control_Systems\Underwater_swarm_project\hardware\CAD_underwater_swarm_project\electronics\RP-008154-DS-1-camera-module-3-step\Ensemble11.iam*LocalDocs*xAaaaqraaAaaaaaaaAaaaaux1Rd*MCKN.ipt
- **D:\Documents\Tibo\ECOLE\NTUST\Intelligent_Control_Systems\Underwater_swarm_project\hardware\CAD_underwater_swarm_project\electronics\RP-008154-DS-1-camera-module-3-step\Ensemble11.iam*LocalDocs*xAaaaqabaAaaaaaaaAaaaakmz1d*MCLK.ipt
- **D:\Documents\Tibo\ECOLE\NTUST\Intelligent_Control_Systems\Underwater_swarm_project\hardware\CAD_underwater_swarm_project\electronics\RP-008154-DS-1-camera-module-3-step\Ensemble11.iam*LocalDocs*xAaaaqcdaAaaaaaaaAaaaqvj3Fh*MD0N.ipt
- **D:\Documents\Tibo\ECOLE\NTUST\Intelligent_Control_Systems\Underwater_swarm_project\hardware\CAD_underwater_swarm_project\electronics\RP-008154-DS-1-camera-module-3-step\Ensemble11.iam*LocalDocs*xAaaaqbdaAaaaaaaaAaaaa1zdLd*MD0P.ipt
- **D:\Documents\Tibo\ECOLE\NTUST\Intelligent_Control_Systems\Underwater_swarm_project\hardware\CAD_underwater_swarm_project\electronics\RP-008154-DS-1-camera-module-3-step\Ensemble11.iam*LocalDocs*xAaaaazdaAaaaaaaaAaaaaxmlKc*MECHANICAL PIN_1.ipt
- **D:\Documents\Tibo\ECOLE\NTUST\Intelligent_Control_Systems\Underwater_swarm_project\hardware\CAD_underwater_swarm_project\electronics\RP-008154-DS-1-camera-module-3-step\Ensemble11.iam*LocalDocs*xAaaaqvbaAaaaaaaaAaaaqyv42e*MECHANICAL PIN_3.ipt
- **D:\Documents\Tibo\ECOLE\NTUST\Intelligent_Control_Systems\Underwater_swarm_project\hardware\CAD_underwater_swarm_project\electronics\RP-008154-DS-1-camera-module-3-step\Ensemble11.iam*LocalDocs*xAaaaqdcaAaaaaaaaAaaaqzfkVe*MECHANICAL PIN_4.ipt
- **D:\Documents\Tibo\ECOLE\NTUST\Intelligent_Control_Systems\Underwater_swarm_project\hardware\CAD_underwater_swarm_project\electronics\RP-008154-DS-1-camera-module-3-step\Ensemble11.iam*LocalDocs*xAaaaqtbaAaaaaaaaAaaaambpOb*MECHANICAL PIN_5.ipt
- **D:\Documents\Tibo\ECOLE\NTUST\Intelligent_Control_Systems\Underwater_swarm_project\hardware\CAD_underwater_swarm_project\electronics\RP-008154-DS-1-camera-module-3-step\Ensemble11.iam*LocalDocs*xAaaaqfaaAaaaaaaaAaaaa1tlHd*NC.ipt
- **D:\Documents\Tibo\ECOLE\NTUST\Intelligent_Control_Systems\Underwater_swarm_project\hardware\CAD_underwater_swarm_project\electronics\RP-008154-DS-1-camera-module-3-step\Ensemble11.iam*LocalDocs*xAaaaq3daAaaaaaaaAaaaaatoBa*NC_1.ipt
- **D:\Documents\Tibo\ECOLE\NTUST\Intelligent_Control_Systems\Underwater_swarm_project\hardware\CAD_underwater_swarm_project\electronics\RP-008154-DS-1-camera-module-3-step\Ensemble11.iam*LocalDocs*xAaaaqhcaAaaaaaaaAaaaao43Ld*NC1_2.ipt
- **D:\Documents\Tibo\ECOLE\NTUST\Intelligent_Control_Systems\Underwater_swarm_project\hardware\CAD_underwater_swarm_project\electronics\RP-008154-DS-1-camera-module-3-step\Ensemble11.iam*LocalDocs*xAaaaqsdaAaaaaaaaAaaaateyEf*NC3_1.ipt
- **D:\Documents\Tibo\ECOLE\NTUST\Intelligent_Control_Systems\Underwater_swarm_project\hardware\CAD_underwater_swarm_project\electronics\RP-008154-DS-1-camera-module-3-step\Ensemble11.iam*LocalDocs*xAaaaqnbaAaaaaaaaAaaaaxov1e*NC4.ipt
- **D:\Documents\Tibo\ECOLE\NTUST\Intelligent_Control_Systems\Underwater_swarm_project\hardware\CAD_underwater_swarm_project\electronics\RP-008154-DS-1-camera-module-3-step\Ensemble11.iam*LocalDocs*xAaaaq1daAaaaaaaaAaaaahgvCf*NC7.ipt
- **D:\Documents\Tibo\ECOLE\NTUST\Intelligent_Control_Systems\Underwater_swarm_project\hardware\CAD_underwater_swarm_project\electronics\RP-008154-DS-1-camera-module-3-step\Ensemble11.iam*LocalDocs*xAaaaqobaAaaaaaaaAaaaah2vIa*NC7_1.ipt
- **D:\Documents\Tibo\ECOLE\NTUST\Intelligent_Control_Systems\Underwater_swarm_project\hardware\CAD_underwater_swarm_project\electronics\RP-008154-DS-1-camera-module-3-step\Ensemble11.iam*LocalDocs*xAaaaqmbaAaaaaaaaAaaaqwjjGf*OUT.ipt
- **D:\Documents\Tibo\ECOLE\NTUST\Intelligent_Control_Systems\Underwater_swarm_project\hardware\CAD_underwater_swarm_project\electronics\RP-008154-DS-1-camera-module-3-step\Ensemble11.iam*LocalDocs*xAaaaaxcaAaaaaaaaAaaaaczxEe*OUT_1.ipt
- **D:\Documents\Tibo\ECOLE\NTUST\Intelligent_Control_Systems\Underwater_swarm_project\hardware\CAD_underwater_swarm_project\electronics\RP-008154-DS-1-camera-module-3-step\Ensemble11.iam*LocalDocs*xAaaaqsaaAaaaaaaaAaaaaucaNg*P1_1.ipt
- **D:\Documents\Tibo\ECOLE\NTUST\Intelligent_Control_Systems\Underwater_swarm_project\hardware\CAD_underwater_swarm_project\electronics\RP-008154-DS-1-camera-module-3-step\Ensemble11.iam*LocalDocs*xAaaaqydaAaaaaaaaAaaaqbbpYf*P1_2.ipt
- **D:\Documents\Tibo\ECOLE\NTUST\Intelligent_Control_Systems\Underwater_swarm_project\hardware\CAD_underwater_swarm_project\electronics\RP-008154-DS-1-camera-module-3-step\Ensemble11.iam*LocalDocs*xAaaaqycaAaaaaaaaAaaaqmjuIg*P2_1.ipt
- **D:\Documents\Tibo\ECOLE\NTUST\Intelligent_Control_Systems\Underwater_swarm_project\hardware\CAD_underwater_swarm_project\electronics\RP-008154-DS-1-camera-module-3-step\Ensemble11.iam*LocalDocs*xAaaaqsdaAaaaaaaaAaaaa5kf3g*P2_2.ipt
- **D:\Documents\Tibo\ECOLE\NTUST\Intelligent_Control_Systems\Underwater_swarm_project\hardware\CAD_underwater_swarm_project\electronics\RP-008154-DS-1-camera-module-3-step\Ensemble11.iam*LocalDocs*xAaaaqbcaAaaaaaaaAaaaqylh5f*P3_1.ipt
- **D:\Documents\Tibo\ECOLE\NTUST\Intelligent_Control_Systems\Underwater_swarm_project\hardware\CAD_underwater_swarm_project\electronics\RP-008154-DS-1-camera-module-3-step\Ensemble11.iam*LocalDocs*xAaaaqoaaAaaaaaaaAaaaaqwpTh*S2.ipt
- **D:\Documents\Tibo\ECOLE\NTUST\Intelligent_Control_Systems\Underwater_swarm_project\hardware\CAD_underwater_swarm_project\electronics\RP-008154-DS-1-camera-module-3-step\Ensemble11.iam*LocalDocs*xAaaaq4baAaaaaaaaAaaaa5tjCg*SCL_1.ipt
- **D:\Documents\Tibo\ECOLE\NTUST\Intelligent_Control_Systems\Underwater_swarm_project\hardware\CAD_underwater_swarm_project\electronics\RP-008154-DS-1-camera-module-3-step\Ensemble11.iam*LocalDocs*xAaaaqkaaAaaaaaaaAaaaqg5a1b*SCL_2.ipt
- **D:\Documents\Tibo\ECOLE\NTUST\Intelligent_Control_Systems\Underwater_swarm_project\hardware\CAD_underwater_swarm_project\electronics\RP-008154-DS-1-camera-module-3-step\Ensemble11.iam*LocalDocs*xAaaaqxbaAaaaaaaaAaaaauedEa*SDA_1.ipt
- **D:\Documents\Tibo\ECOLE\NTUST\Intelligent_Control_Systems\Underwater_swarm_project\hardware\CAD_underwater_swarm_project\electronics\RP-008154-DS-1-camera-module-3-step\Ensemble11.iam*LocalDocs*xAaaaqycaAaaaaaaaAaaaaddnZa*SDA_2.ipt
- **D:\Documents\Tibo\ECOLE\NTUST\Intelligent_Control_Systems\Underwater_swarm_project\hardware\CAD_underwater_swarm_project\electronics\RP-008154-DS-1-camera-module-3-step\Ensemble11.iam*LocalDocs*xAaaaqebaAaaaaaaaAaaaq3nvZg*VA2V8.ipt
- **D:\Documents\Tibo\ECOLE\NTUST\Intelligent_Control_Systems\Underwater_swarm_project\hardware\CAD_underwater_swarm_project\electronics\RP-008154-DS-1-camera-module-3-step\Ensemble11.iam*LocalDocs*xAaaaq5aaAaaaaaaaAaaaqidf2b*VCC_1.ipt
- **D:\Documents\Tibo\ECOLE\NTUST\Intelligent_Control_Systems\Underwater_swarm_project\hardware\CAD_underwater_swarm_project\electronics\RP-008154-DS-1-camera-module-3-step\Ensemble11.iam*LocalDocs*xAaaaq5aaAaaaaaaaAaaaq1rgDe*VIN.ipt
- **D:\Documents\Tibo\ECOLE\NTUST\Intelligent_Control_Systems\Underwater_swarm_project\hardware\CAD_underwater_swarm_project\electronics\RP-008154-DS-1-camera-module-3-step\Ensemble11.iam*LocalDocs*xAaaaq3aaAaaaaaaaAaaaqbirYd*CAPC1005X55N_11.ipt
- **D:\Documents\Tibo\ECOLE\NTUST\Intelligent_Control_Systems\Underwater_swarm_project\hardware\CAD_underwater_swarm_project\electronics\RP-008154-DS-1-camera-module-3-step\Ensemble11.iam*LocalDocs*xAaaaqjaaAaaaaaaaAaaaqjrdLh*SOT50P160X60-6N.ipt
- **D:\Documents\Tibo\ECOLE\NTUST\Intelligent_Control_Systems\Underwater_swarm_project\hardware\CAD_underwater_swarm_project\electronics\RP-008154-DS-1-camera-module-3-step\Ensemble11.iam*LocalDocs*xAaaaqcaaAaaaaaaaAaaaqncwBd*BOURNS_SRN2512.ipt
- **D:\Documents\Tibo\ECOLE\NTUST\Intelligent_Control_Systems\Underwater_swarm_project\hardware\CAD_underwater_swarm_project\electronics\RP-008154-DS-1-camera-module-3-step\Ensemble11.iam*LocalDocs*xAaaaqadaAaaaaaaaAaaaaui25g*CAPC1005X55N_10.ipt
- **D:\Documents\Tibo\ECOLE\NTUST\Intelligent_Control_Systems\Underwater_swarm_project\hardware\CAD_underwater_swarm_project\electronics\RP-008154-DS-1-camera-module-3-step\Ensemble11.iam*LocalDocs*xAaaaqabaAaaaaaaaAaaaahu4Kd*CAPC1005X55N_6.ipt
- **D:\Documents\Tibo\ECOLE\NTUST\Intelligent_Control_Systems\Underwater_swarm_project\hardware\CAD_underwater_swarm_project\electronics\RP-008154-DS-1-camera-module-3-step\Ensemble11.iam*LocalDocs*xAaaaqbcaAaaaaaaaAaaaqpyiXf*Symbols.iam
- **D:\Documents\Tibo\ECOLE\NTUST\Intelligent_Control_Systems\Underwater_swarm_project\hardware\CAD_underwater_swarm_project\electronics\RP-008154-DS-1-camera-module-3-step\Ensemble11.iam*LocalDocs*xAaaaqiaaAaaaaaaaAaaaq4kw3b*AP3445.ipt
- **D:\Documents\Tibo\ECOLE\NTUST\Intelligent_Control_Systems\Underwater_swarm_project\hardware\CAD_underwater_swarm_project\electronics\RP-008154-DS-1-camera-module-3-step\Ensemble11.iam*LocalDocs*xAaaaqeaaAaaaaaaaAaaaqwmkVf*CAPC1005X55N_3.ipt
- **D:\Documents\Tibo\ECOLE\NTUST\Intelligent_Control_Systems\Underwater_swarm_project\hardware\CAD_underwater_swarm_project\electronics\RP-008154-DS-1-camera-module-3-step\Ensemble11.iam*LocalDocs*xAaaaqqbaAaaaaaaaAaaaquyzRg*CAPC1005X55N_7.ipt
- **D:\Documents\Tibo\ECOLE\NTUST\Intelligent_Control_Systems\Underwater_swarm_project\hardware\CAD_underwater_swarm_project\electronics\RP-008154-DS-1-camera-module-3-step\Ensemble11.iam*LocalDocs*xAaaaqkaaAaaaaaaaAaaaajm3Pb*CAPC1005X55N_9.ipt
- **D:\Documents\Tibo\ECOLE\NTUST\Intelligent_Control_Systems\Underwater_swarm_project\hardware\CAD_underwater_swarm_project\electronics\RP-008154-DS-1-camera-module-3-step\Ensemble11.iam*LocalDocs*xAaaaqidaAaaaaaaaAaaaqw0o2g*HIROSE_DF37NC-30DS-04V.ipt
- **D:\Documents\Tibo\ECOLE\NTUST\Intelligent_Control_Systems\Underwater_swarm_project\hardware\CAD_underwater_swarm_project\electronics\RP-008154-DS-1-camera-module-3-step\Ensemble11.iam*LocalDocs*xAaaaqwaaAaaaaaaaAaaaqkb3Ab*MURATA_DLP11SNXXXHL2_1.ipt
- **D:\Documents\Tibo\ECOLE\NTUST\Intelligent_Control_Systems\Underwater_swarm_project\hardware\CAD_underwater_swarm_project\electronics\RP-008154-DS-1-camera-module-3-step\Ensemble11.iam*LocalDocs*xAaaaqtaaAaaaaaaaAaaaqca45c*OSC_2P5X2MM.ipt
- **D:\Documents\Tibo\ECOLE\NTUST\Intelligent_Control_Systems\Underwater_swarm_project\hardware\CAD_underwater_swarm_project\electronics\RP-008154-DS-1-camera-module-3-step\Ensemble11.iam*LocalDocs*xAaaaqfcaAaaaaaaaAaaaatbfAc*RESC0603_1.ipt
- **D:\Documents\Tibo\ECOLE\NTUST\Intelligent_Control_Systems\Underwater_swarm_project\hardware\CAD_underwater_swarm_project\electronics\RP-008154-DS-1-camera-module-3-step\Ensemble11.iam*LocalDocs*xAaaaqrbaAaaaaaaaAaaaanziLd*RESC1005X40N.ipt
- **D:\Documents\Tibo\ECOLE\NTUST\Intelligent_Control_Systems\Underwater_swarm_project\hardware\CAD_underwater_swarm_project\electronics\RP-008154-DS-1-camera-module-3-step\Ensemble11.iam*LocalDocs*xAaaaqndaAaaaaaaaAaaaak5aIa*RESC1005X40N_2.ipt
- **D:\Documents\Tibo\ECOLE\NTUST\Intelligent_Control_Systems\Underwater_swarm_project\hardware\CAD_underwater_swarm_project\electronics\RP-008154-DS-1-camera-module-3-step\Ensemble11.iam*LocalDocs*xAaaaqkdaAaaaaaaaAaaaqv5k2d*SOT95P280X145-5N.ipt
- **D:\Documents\Tibo\ECOLE\NTUST\Intelligent_Control_Systems\Underwater_swarm_project\hardware\CAD_underwater_swarm_project\electronics\RP-008154-DS-1-camera-module-3-step\Ensemble11.iam*LocalDocs*xAaaaqzcaAaaaaaaaAaaaax1cQf*Camera_module_3_std_model_simple.iam
- D:\Documents\Tibo\ECOLE\NTUST\Intelligent_Control_Systems\Underwater_swarm_project\hardware\CAD_underwater_swarm_project\electronics\RP-008154-DS-1-camera-module-3-step\Ensemble11.iam
- D:\Documents\Tibo\ECOLE\NTUST\Intelligent_Control_Systems\Underwater_swarm_project\hardware\CAD_underwater_swarm_project\electronics\RP-008154-DS-1-camera-module-3-step\Camera_module_3_std_model_simple.stp
## Components (1 placed, 1 different names)
1. Camera_module_3_std_model_simple:1 [sub-assembly]
